# Autodesk Inventor assembly: Assy_linear_module
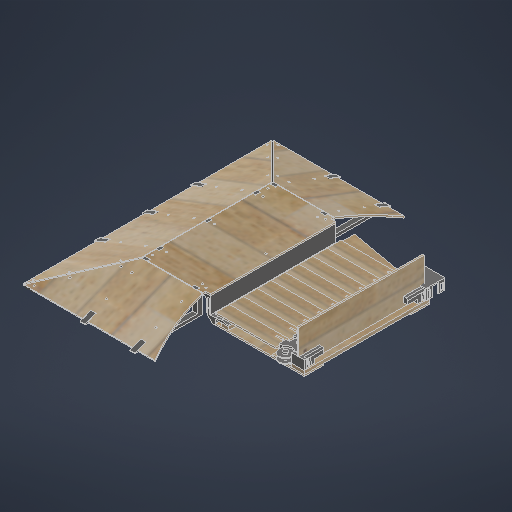
[picture p0: Inventor's stored thumbnail of the model, 512x512]
Saved by Autodesk Inventor 2027.1 (Build 311270010, 270A)
## iProperties
Created: 2025-09-27
Part Number: Assy_linear_module
Document SubType Name: Assembly
Designer: hibik
Author: hibik
## Documents named in this file (19)
- D:\model\D2_Conveyor_2026\liniar_module\Assy_linear_module_Slope.iam
- D:\model\D2_Conveyor_2026\liniar_module\base.ipt
- D:\model\D2_Conveyor_2026\liniar_module\connector_base.ipt
- D:\model\D2_Conveyor_2026\liniar_module\back_upper.ipt
- D:\model\D2_Conveyor_2026\connectors\connector_male.ipt
- D:\model\D2_Conveyor_2026\liniar_module\belt_rail.ipt
- D:\model\D2_Conveyor_2026\liniar_module\front.ipt
- D:\model\D2_Conveyor_2026\belt\belt_linear.iam
- D:\model\D2_Conveyor_2026\connectors\connetcor_female_cover.ipt
- D:\model\D2_Conveyor_2026\liniar_module\wall.ipt
- D:\model\D2_Conveyor_2026\liniar_module\front_rail.ipt
- D:\model\D2_Conveyor_2026\liniar_module\Front_Rail_Wall_Slope.ipt
- D:\model\D2_Conveyor_2026\liniar_module\Stage.ipt
- D:\model\D2_Conveyor_2026\liniar_module\Slope_Stand.ipt
- D:\model\D2_Conveyor_2026\liniar_module\Slope_Front.ipt
- D:\model\D2_Conveyor_2026\liniar_module\Slope_Left.ipt
- D:\model\D2_Conveyor_2026\liniar_module\Slope_Right.ipt
- D:\model\D2_Conveyor_2026\Slope_Support.ipt
- D:\model\D2_Conveyor_2026\Slope_Support_MIR.ipt
## Components (26 placed, 18 different names)
1. base:1 — メイト:1, フラッシュ:1, フラッシュ:3, メイト:7, フラッシュ:7, フラッシュ:8, フラッシュ:9, メイト:12, フラッシュ:11
2. connector_base:1 — メイト:1, フラッシュ:1, フラッシュ:3, メイト:3, フラッシュ:5, フラッシュ:6, メイト:4, メイト:5, メイト:6, メイト:8, メイト:9, メイト:10, メイト:11, メイト:13, メイト:14, メイト:19
3. base:2 — メイト:3, フラッシュ:5, フラッシュ:6
4. connector_male:7 — メイト:9, メイト:10, メイト:11, メイト:16
5. connector_male:8 — メイト:4, メイト:5, メイト:6, メイト:17, メイト:18
6. belt_rail:1 — メイト:7, フラッシュ:7, メイト:8, 正接:1
7. front:1 — フラッシュ:8, フラッシュ:9, メイト:12, メイト:20, メイト:21, メイト:22
8. back_upper:1 — フラッシュ:10, メイト:13, メイト:14, メイト:15
9. belt_linear:1 [sub-assembly] — メイト:15, 正接:1, フラッシュ:11
10. connetcor_female_cover:1 — メイト:16
11. wall:1 — メイト:17, メイト:18, メイト:19
12. front_rail:1 — メイト:20, メイト:21, メイト:22, メイト:23, フラッシュ:12, メイト:24
13. Front_Rail_Wall_Slope:1 — メイト:23, フラッシュ:12, メイト:24, 回転:1, メイト:25
14. Slope_Front:1 — 回転:2, メイト:29, 回転:6, メイト:48
15. Slope_Stand:7 — メイト:41, メイト:42, メイト:43, メイト:44
16. Slope_Stand:8 — メイト:26, メイト:27, メイト:28, 回転:2, メイト:29, フラッシュ:16, フラッシュ:17
17. Slope_Stand:9 — メイト:38, メイト:39, メイト:40, メイト:45
18. Slope_Stand:10 — メイト:33, メイト:34, メイト:35, 回転:3, メイト:36
19. Stage:1 — 回転:1, メイト:25, メイト:26, メイト:27, メイト:28, メイト:30, メイト:31, メイト:32, メイト:33, メイト:34, メイト:35, メイト:38, メイト:39, メイト:40, メイト:41, メイト:42, メイト:43
20. Slope_Right:1 — 回転:4, メイト:37, メイト:47
21. Slope_Left:1 — 回転:3, メイト:36, メイト:46
22. Slope_Stand:12 — メイト:30, メイト:31, メイト:32, 回転:4, メイト:37
23. Slope_Stand:13 — フラッシュ:15, フラッシュ:18, メイト:45
24. Slope_Stand:14 — フラッシュ:15, フラッシュ:16, フラッシュ:17, フラッシュ:18, メイト:44
25. Slope_Support:1 — 回転:6, メイト:46
26. Slope_Support_MIR:1 — メイト:47, メイト:48
## Relationships (67: Mate 47, Flush 14, RevoluteJoint 5, Tangent 1)
- メイト:1 [Mate]: base:1 ↔ connector_base:1
- フラッシュ:1 [Flush]: base:1 ↔ connector_base:1
- フラッシュ:3 [Flush]: base:1 ↔ connector_base:1
- メイト:3 [Mate]: connector_base:1 ↔ base:2
- フラッシュ:5 [Flush]: connector_base:1 ↔ base:2
- フラッシュ:6 [Flush]: connector_base:1 ↔ base:2
- メイト:4 [Mate]: connector_base:1 ↔ connector_male:8
- メイト:5 [Mate]: connector_base:1 ↔ connector_male:8
- メイト:6 [Mate]: connector_base:1 ↔ connector_male:8
- メイト:7 [Mate]: base:1 ↔ belt_rail:1
- フラッシュ:7 [Flush]: base:1 ↔ belt_rail:1
- メイト:8 [Mate]: connector_base:1 ↔ belt_rail:1
- メイト:9 [Mate]: connector_base:1 ↔ connector_male:7
- メイト:10 [Mate]: connector_base:1 ↔ connector_male:7
- メイト:11 [Mate]: connector_base:1 ↔ connector_male:7
- フラッシュ:8 [Flush]: base:1 ↔ front:1
- フラッシュ:9 [Flush]: base:1 ↔ front:1
- メイト:12 [Mate]: base:1 ↔ front:1
- フラッシュ:10 [Flush]: back_upper:1
- メイト:13 [Mate]: connector_base:1 ↔ back_upper:1
- メイト:14 [Mate]: connector_base:1 ↔ back_upper:1
- メイト:15 [Mate]: back_upper:1 ↔ belt_linear:1
- 正接:1 [Tangent]: belt_rail:1 ↔ belt_linear:1
- フラッシュ:11 [Flush]: base:1 ↔ belt_linear:1
- メイト:16 [Mate]: connector_male:7 ↔ connetcor_female_cover:1
- メイト:17 [Mate]: connector_male:8 ↔ wall:1
- メイト:18 [Mate]: connector_male:8 ↔ wall:1
- メイト:19 [Mate]: connector_base:1 ↔ wall:1
- メイト:20 [Mate]: front:1 ↔ front_rail:1
- メイト:21 [Mate]: front:1 ↔ front_rail:1
- メイト:22 [Mate]: front:1 ↔ front_rail:1
- メイト:23 [Mate]: front_rail:1 ↔ Front_Rail_Wall_Slope:1
- フラッシュ:12 [Flush]: front_rail:1 ↔ Front_Rail_Wall_Slope:1
- メイト:24 [Mate]: front_rail:1 ↔ Front_Rail_Wall_Slope:1
- 回転:1 [RevoluteJoint]: Front_Rail_Wall_Slope:1 ↔ Stage:1
- メイト:25 [Mate]: Front_Rail_Wall_Slope:1 ↔ Stage:1
- メイト:26 [Mate]: Slope_Stand:8 ↔ Stage:1
- メイト:27 [Mate]: Slope_Stand:8 ↔ Stage:1
- メイト:28 [Mate]: Slope_Stand:8 ↔ Stage:1
- 回転:2 [RevoluteJoint]: Slope_Front:1 ↔ Slope_Stand:8
- メイト:29 [Mate]: Slope_Front:1 ↔ Slope_Stand:8
- メイト:30 [Mate]: Stage:1 ↔ Slope_Stand:12
- メイト:31 [Mate]: Stage:1 ↔ Slope_Stand:12
- メイト:32 [Mate]: Stage:1 ↔ Slope_Stand:12
- メイト:33 [Mate]: Slope_Stand:10 ↔ Stage:1
- メイト:34 [Mate]: Slope_Stand:10 ↔ Stage:1
- メイト:35 [Mate]: Slope_Stand:10 ↔ Stage:1
- 回転:3 [RevoluteJoint]: Slope_Stand:10 ↔ Slope_Left:1
- メイト:36 [Mate]: Slope_Stand:10 ↔ Slope_Left:1
- 回転:4 [RevoluteJoint]: Slope_Right:1 ↔ Slope_Stand:12
- メイト:37 [Mate]: Slope_Right:1 ↔ Slope_Stand:12
- メイト:38 [Mate]: Slope_Stand:9 ↔ Stage:1
- メイト:39 [Mate]: Slope_Stand:9 ↔ Stage:1
- メイト:40 [Mate]: Slope_Stand:9 ↔ Stage:1
- メイト:41 [Mate]: Slope_Stand:7 ↔ Stage:1
- メイト:42 [Mate]: Slope_Stand:7 ↔ Stage:1
- メイト:43 [Mate]: Slope_Stand:7 ↔ Stage:1
- フラッシュ:15 [Flush]: Slope_Stand:13 ↔ Slope_Stand:14
- フラッシュ:16 [Flush]: Slope_Stand:8 ↔ Slope_Stand:14
- フラッシュ:17 [Flush]: Slope_Stand:8 ↔ Slope_Stand:14
- フラッシュ:18 [Flush]: Slope_Stand:13 ↔ Slope_Stand:14
- メイト:44 [Mate] (15 mm): Slope_Stand:7 ↔ Slope_Stand:14
- メイト:45 [Mate] (15 mm): Slope_Stand:9 ↔ Slope_Stand:13
- 回転:6 [RevoluteJoint]: Slope_Front:1 ↔ Slope_Support:1
- メイト:46 [Mate]: Slope_Left:1 ↔ Slope_Support:1
- メイト:47 [Mate]: Slope_Right:1 ↔ Slope_Support_MIR:1
- メイト:48 [Mate]: Slope_Front:1 ↔ Slope_Support_MIR:1
